# Autodesk Inventor assembly: 完整装配体
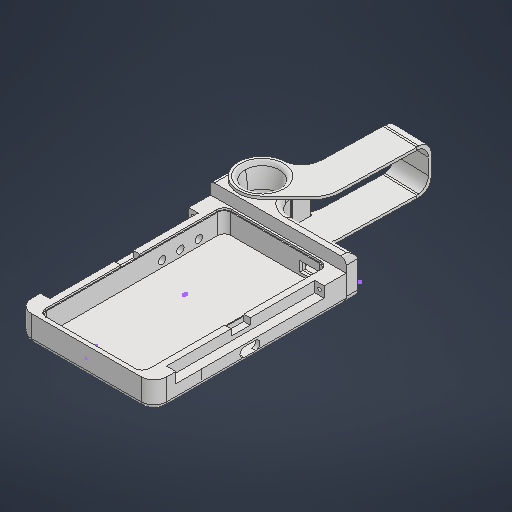
[picture p0: Inventor's stored thumbnail of the model, 512x512]
Saved by Autodesk Inventor 2025 (Build 290162000, 162)
## iProperties
Created: 2025-08-26
Part Number: 完整装配体
Document SubType Name: Assembly
Designer: HZD
Author: HZD
## Documents named in this file (16)
- D:\2 B Mechanical design\Bright\完整装配体.iam
- D:\2 B Mechanical design\Bright\散落零件\方案三（3-5+遥控器0826）.ipt
- D:\2 B Mechanical design\Bright\散落零件\零件3.ipt
- D:\2 B Mechanical design\Bright\散落零件\外盖板.iam
- D:\2 B Mechanical design\Bright\散落零件\遥控器0826.ipt
- D:\2 B Mechanical design\Bright\散落零件\零件11.ipt
- D:\2 B Mechanical design\Bright\铰链\荷叶模块.iam
- D:\2 B Mechanical design\Bright\铰链\连杆.ipt
- D:\2 B Mechanical design\Bright\散落零件\外盖板_2.iam
- D:\2 B Mechanical design\Bright\铰链\荷叶模块_2.iam
- D:\2 B Mechanical design\Bright\铰链\连杆_2.ipt
- D:\2 B Mechanical design\Bright\散落零件\铰链.iam
- D:\2 B Mechanical design\Bright\散落零件\背面贴纸.ipt
- D:\2 B Mechanical design\Bright\散落零件\电池.ipt
- D:\2 B Mechanical design\Bright\散落零件\显示屏电路板.ipt
- D:\2 B Mechanical design\Bright\散落零件\按钮1.ipt
## Components (22 placed, 15 different names)
1. 方案三（3-5+遥控器0826）:1 — 配合:59, 配合:60, 配合:61, 配合:62, 表面齐平:1, 表面齐平:2, 配合:64, 配合:65, 配合:67, 配合:68, 配合:69, 配合:70, 配合:71
2. 零件3:1 — 配合:67
3. 遥控器0826:1
4. 外盖板:2 [sub-assembly] — 配合:63, 表面齐平:1, 表面齐平:2
5. 荷叶模块:1 [sub-assembly] — 配合:33, 配合:34, 配合:39, 配合:42, 配合:43, 配合:44
6. 连杆:1 — 配合:34, 配合:43
7. 连杆:2 — 配合:33
8. 连杆:4 — 配合:39
9. 连杆:5 — 配合:42, 配合:44
10. 外盖板_2:1 [sub-assembly]
11. 荷叶模块_2:1 [sub-assembly] — 配合:45, 配合:46, 配合:47, 配合:51, 配合:52, 配合:53
12. 连杆_2:1 — 配合:45, 配合:46
13. 连杆_2:2 — 配合:47
14. 连杆_2:3 — 配合:51
15. 连杆_2:4 — 配合:52, 配合:53
16. 零件11:1 — 配合:59, 配合:60
17. 铰链:1 [sub-assembly] — 配合:61, 配合:62, 配合:63
18. 背面贴纸:1 — 配合:64, 配合:65
19. 电池:1 — 配合:69, 表面齐平:3
20. 电池:2 — 配合:68, 表面齐平:3
21. 显示屏电路板:1 — 配合:70
22. 按钮1:1 — 配合:71
## Relationships (27: Mate 24, Flush 3)
- 配合:33 [Mate]: 荷叶模块:1 ↔ 连杆:2
- 配合:34 [Mate]: 荷叶模块:1 ↔ 连杆:1
- 配合:39 [Mate]: 荷叶模块:1 ↔ 连杆:4
- 配合:42 [Mate]: 荷叶模块:1 ↔ 连杆:5
- 配合:43 [Mate] (0.1 mm): 荷叶模块:1 ↔ 连杆:1
- 配合:44 [Mate] (0.1 mm): 荷叶模块:1 ↔ 连杆:5
- 配合:45 [Mate] (0.1 mm): 荷叶模块_2:1 ↔ 连杆_2:1
- 配合:46 [Mate]: 荷叶模块_2:1 ↔ 连杆_2:1
- 配合:47 [Mate]: 荷叶模块_2:1 ↔ 连杆_2:2
- 配合:51 [Mate]: 荷叶模块_2:1 ↔ 连杆_2:3
- 配合:52 [Mate] (0.1 mm): 荷叶模块_2:1 ↔ 连杆_2:4
- 配合:53 [Mate]: 荷叶模块_2:1 ↔ 连杆_2:4
- 配合:59 [Mate] (4 mm): 方案三（3-5+遥控器0826）:1 ↔ 零件11:1
- 配合:60 [Mate]: 方案三（3-5+遥控器0826）:1 ↔ 零件11:1
- 配合:61 [Mate]: 方案三（3-5+遥控器0826）:1 ↔ 铰链:1
- 配合:62 [Mate]: 方案三（3-5+遥控器0826）:1 ↔ 铰链:1
- 配合:63 [Mate]: 外盖板:2 ↔ 铰链:1
- 表面齐平:1 [Flush]: 方案三（3-5+遥控器0826）:1 ↔ 外盖板:2
- 表面齐平:2 [Flush]: 方案三（3-5+遥控器0826）:1 ↔ 外盖板:2
- 配合:64 [Mate]: 方案三（3-5+遥控器0826）:1 ↔ 背面贴纸:1
- 配合:65 [Mate]: 方案三（3-5+遥控器0826）:1 ↔ 背面贴纸:1
- 配合:67 [Mate]: 方案三（3-5+遥控器0826）:1 ↔ 零件3:1
- 配合:68 [Mate]: 方案三（3-5+遥控器0826）:1 ↔ 电池:2
- 配合:69 [Mate]: 方案三（3-5+遥控器0826）:1 ↔ 电池:1
- 表面齐平:3 [Flush]: 电池:1 ↔ 电池:2
- 配合:70 [Mate]: 方案三（3-5+遥控器0826）:1 ↔ 显示屏电路板:1
- 配合:71 [Mate]: 方案三（3-5+遥控器0826）:1 ↔ 按钮1:1
